# Autodesk Inventor assembly: SJH50-W699S-E_OPEN_ASM
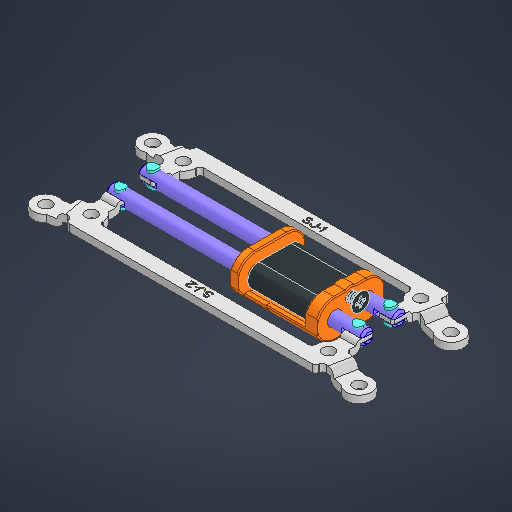
[picture p0: Inventor's stored thumbnail of the model, 512x512]
Saved by Autodesk Inventor 2025 (Build 290162000, 162)
## iProperties
Created: 2025-12-17
Part Number: SJH50-W699S-E_OPEN_ASM
Document SubType Name: Assembly
Designer: HZD
Sending System: Autodesk Inventor 2025
Preprocessor: ST-DEVELOPER v20
Title: sjh50-w699s-e_open_asm.stp
Author: HZD
Revision Number: 1LAST_VERSION
## Documents named in this file (10)
- D:\2 B Mechanical design\Bright\官方铰链\sjh50-w699s-e_open_asm.iam
- D:\2 B Mechanical design\Bright\官方铰链\SJH50-W699S-D_CASE_ASM.iam
- D:\2 B Mechanical design\Bright\官方铰链\SJH50-W699S_ZN-CASTING_24_1_23_.ipt
- D:\2 B Mechanical design\Bright\官方铰链\SJH50-W699S_POM-FPC_8_1_4_1.ipt
- D:\2 B Mechanical design\Bright\官方铰链\SJHH50-W699S_SHAFT-ASSY_ASM_4_A_ASM.iam
- D:\2 B Mechanical design\Bright\官方铰链\SJH50-W699S-C_PRESS-PART_ASM_4__ASM.iam
- D:\2 B Mechanical design\Bright\官方铰链\SCREW-M14X2_3_1.ipt
- D:\2 B Mechanical design\Bright\官方铰链\SJT01004-SCREW_4_1.ipt
- D:\2 B Mechanical design\Bright\官方铰链\SJH50-W699S-A_RIVET_ASM_1_ASM.iam
- D:\2 B Mechanical design\Bright\官方铰链\SJH50-W699S-C_PRESS-PART2_3_1.ipt
## Components (11 placed, 11 different names)
1. SJH50-W699S-D_CASE_ASM_143 [sub-assembly] — 配合:3, 配合:10
2. SJH50-W699S_ZN-CASTING_24_1_23__144 — 配合:2, 配合:11
3. SJH50-W699S_POM-FPC_8_1_4_1_145
4. SJHH50-W699S_SHAFT-ASSY_ASM_4_A_ASM_148 [sub-assembly] — 配合:1, 配合:2, 配合:3, 配合:5, 配合:9
5. SJH50-W699S-C_PRESS-PART_ASM_4__ASM_151 [sub-assembly] — 配合:5, 配合:6, 配合:10, 表面齐平:1
6. SCREW-M14X2_3_1_152
7. SJT01004-SCREW_4_1_153
8. SJH50-W699S-A_RIVET_ASM_1_ASM_167 [sub-assembly] — 配合:1, 配合:6, 配合:9
9. SJH50-W699S-C_PRESS-PART2_3_1:1 — 配合:12, 配合:13, 配合:14, 表面齐平:1
10. SJHH50-W699S_SHAFT-ASSY_ASM_4_A_ASM:2 [sub-assembly] — 配合:11, 配合:12, 配合:13, 配合:14, 配合:15
11. SJH50-W699S-A_RIVET_ASM_1_ASM:2 [sub-assembly] — 配合:15
## Relationships (13: Mate 12, Flush 1)
- 配合:1 [Mate]: SJHH50-W699S_SHAFT-ASSY_ASM_4_A_ASM_148 ↔ SJH50-W699S-A_RIVET_ASM_1_ASM_167
- 配合:2 [Mate]: SJH50-W699S_ZN-CASTING_24_1_23__144 ↔ SJHH50-W699S_SHAFT-ASSY_ASM_4_A_ASM_148
- 配合:3 [Mate]: SJH50-W699S-D_CASE_ASM_143 ↔ SJHH50-W699S_SHAFT-ASSY_ASM_4_A_ASM_148
- 配合:5 [Mate]: SJHH50-W699S_SHAFT-ASSY_ASM_4_A_ASM_148 ↔ SJH50-W699S-C_PRESS-PART_ASM_4__ASM_151
- 配合:6 [Mate]: SJH50-W699S-C_PRESS-PART_ASM_4__ASM_151 ↔ SJH50-W699S-A_RIVET_ASM_1_ASM_167
- 配合:9 [Mate]: SJHH50-W699S_SHAFT-ASSY_ASM_4_A_ASM_148 ↔ SJH50-W699S-A_RIVET_ASM_1_ASM_167
- 配合:10 [Mate] (1 mm): SJH50-W699S-D_CASE_ASM_143 ↔ SJH50-W699S-C_PRESS-PART_ASM_4__ASM_151
- 配合:11 [Mate]: SJH50-W699S_ZN-CASTING_24_1_23__144 ↔ SJHH50-W699S_SHAFT-ASSY_ASM_4_A_ASM:2
- 配合:12 [Mate]: SJH50-W699S-C_PRESS-PART2_3_1:1 ↔ SJHH50-W699S_SHAFT-ASSY_ASM_4_A_ASM:2
- 配合:13 [Mate]: SJH50-W699S-C_PRESS-PART2_3_1:1 ↔ SJHH50-W699S_SHAFT-ASSY_ASM_4_A_ASM:2
- 配合:14 [Mate]: SJH50-W699S-C_PRESS-PART2_3_1:1 ↔ SJHH50-W699S_SHAFT-ASSY_ASM_4_A_ASM:2
- 配合:15 [Mate]: SJHH50-W699S_SHAFT-ASSY_ASM_4_A_ASM:2 ↔ SJH50-W699S-A_RIVET_ASM_1_ASM:2
- 表面齐平:1 [Flush]: SJH50-W699S-C_PRESS-PART_ASM_4__ASM_151 ↔ SJH50-W699S-C_PRESS-PART2_3_1:1
